# Autodesk Inventor assembly: Prototipo del Vehiculo instrumentado
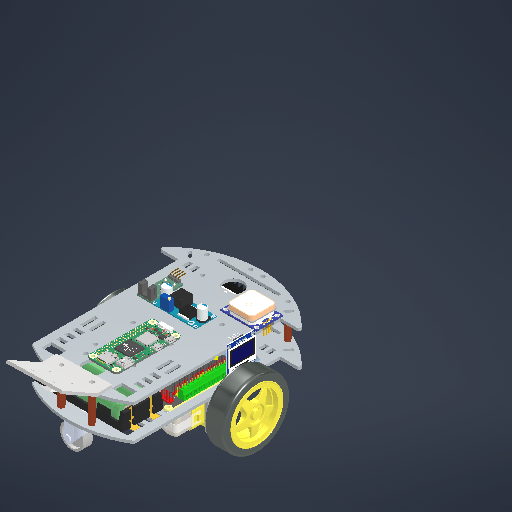
[picture p0: Inventor's stored thumbnail of the model, 512x512]
Saved by Autodesk Inventor 2026.1 (Build 301233020, 233B)
## iProperties
Created: 2026-08-15
Part Number: Prototipo del Vehiculo instrumentado
Document SubType Name: Assembly
Designer: allan
Author: allan
## Documents named in this file (17)
- C:\Users\allan\Downloads\Planos del vehiculo Instrumentado\Ensamble Final\Prototipo del Vehiculo instrumentado.iam
- C:\Users\allan\Downloads\Planos del vehiculo Instrumentado\Chasis con soporte rueda.ipt
- C:\Users\allan\Downloads\Planos del vehiculo Instrumentado\Moto Reductor - Rueda.iam
- C:\Users\allan\Downloads\Planos del vehiculo Instrumentado\Remache.ipt
- C:\Users\allan\Downloads\Planos del vehiculo Instrumentado\Chasis-Superior.ipt
- C:\Users\allan\Downloads\Planos del vehiculo Instrumentado\Rueda loca.ipt
- C:\Users\allan\Downloads\Planos del vehiculo Instrumentado\ESP32 Breakout Board SLDPRT.ipt
- C:\Users\allan\Downloads\Planos del vehiculo Instrumentado\Raspberry Pi Zero 2 W.ipt
- C:\Users\allan\Downloads\Planos del vehiculo Instrumentado\L298N.ipt
- C:\Users\allan\Downloads\Planos del vehiculo Instrumentado\2 Bateria de 18650 3.6 V 2500 mah.iam
- C:\Users\allan\Downloads\Planos del vehiculo Instrumentado\GPS-NEOM8N.iam
- C:\Users\allan\Downloads\Planos del vehiculo Instrumentado\Camara Raspberry OV5647.iam
- C:\Users\allan\Downloads\Planos del vehiculo Instrumentado\Soporte de Camara.ipt
- C:\Users\allan\Downloads\Planos del vehiculo Instrumentado\Regulador Lm2596.ipt
- C:\Users\allan\Downloads\Planos del vehiculo Instrumentado\OLED Display 0.96.ipt
- C:\Users\allan\Downloads\Planos del vehiculo Instrumentado\ADXL345.ipt
- C:\Users\allan\Downloads\Planos del vehiculo Instrumentado\Sensor Lm393.iam
## Components (20 placed, 16 different names)
1. Moto Reductor - Rueda:2 [sub-assembly] — Coincidencia:1, Coincidencia:2
2. Moto Reductor - Rueda:3 [sub-assembly] — Coincidencia:3
3. Chasis con soporte rueda:1 — Coincidencia:1, Coincidencia:2, Coincidencia:3, Coincidencia:4, Coincidencia:5, Coincidencia:6, Coincidencia:7, Coincidencia:14, Coincidencia:15, Coincidencia:34, Coincidencia:36, Coincidencia:37, Coincidencia:38, Coincidencia:43, Coincidencia:45, Coincidencia:46, Coincidencia:47, Coincidencia:48, Coincidencia:64
4. Remache:1 — Coincidencia:4, Coincidencia:5
5. Remache:2 — Coincidencia:6, Coincidencia:7, Coincidencia:12, Coincidencia:13
6. Chasis-Superior:1 — Coincidencia:12, Coincidencia:13, Coincidencia:18, Coincidencia:19, Coincidencia:27, Coincidencia:28, Coincidencia:29, Coincidencia:30, Coincidencia:33, Coincidencia:35, Coincidencia:51, Coincidencia:55, Coincidencia:56, Coincidencia:57, Coincidencia:58, Coincidencia:61, Coincidencia:63, Coincidencia:66
7. Rueda loca:1 — Coincidencia:14, Coincidencia:15
8. Raspberry Pi Zero 2 W:1 — Coincidencia:18, Coincidencia:19
9. Remache:3 — Coincidencia:27, Coincidencia:28, Coincidencia:34
10. Remache:4 — Coincidencia:29, Coincidencia:30
11. GPS-NEOM8N:1 [sub-assembly] — Coincidencia:33, Coincidencia:35, Coincidencia:51, Coincidencia:62
12. Camara Raspberry OV5647:1 [sub-assembly] — Coincidencia:59, Coincidencia:60
13. 2 Bateria de 18650 3.6 V 2500 mah:1 [sub-assembly] — Coincidencia:36, Coincidencia:37, Coincidencia:38, Coincidencia:44
14. ESP32 Breakout Board SLDPRT:1 — Coincidencia:43, Coincidencia:44, Coincidencia:45, Coincidencia:65
15. L298N:1 — Coincidencia:46, Coincidencia:47, Coincidencia:48
16. Regulador Lm2596:1 — Coincidencia:55, Coincidencia:56, Coincidencia:67, Coincidencia:68
17. Soporte de Camara:1 — Coincidencia:57, Coincidencia:58, Coincidencia:59, Coincidencia:60
18. OLED Display 0.96:1 — Coincidencia:61, Coincidencia:62, Coincidencia:63
19. ADXL345:1 — Coincidencia:64, Coincidencia:65
20. Sensor Lm393:1 [sub-assembly] — Coincidencia:66, Coincidencia:67, Coincidencia:68
## Relationships (44: Mate 44)
- Coincidencia:1 [Mate]: Moto Reductor - Rueda:2 ↔ Chasis con soporte rueda:1
- Coincidencia:2 [Mate]: Moto Reductor - Rueda:2 ↔ Chasis con soporte rueda:1
- Coincidencia:3 [Mate]: Moto Reductor - Rueda:3 ↔ Chasis con soporte rueda:1
- Coincidencia:4 [Mate]: Chasis con soporte rueda:1 ↔ Remache:1
- Coincidencia:5 [Mate]: Chasis con soporte rueda:1 ↔ Remache:1
- Coincidencia:6 [Mate]: Chasis con soporte rueda:1 ↔ Remache:2
- Coincidencia:7 [Mate]: Chasis con soporte rueda:1 ↔ Remache:2
- Coincidencia:12 [Mate]: Remache:2 ↔ Chasis-Superior:1
- Coincidencia:13 [Mate]: Remache:2 ↔ Chasis-Superior:1
- Coincidencia:14 [Mate]: Chasis con soporte rueda:1 ↔ Rueda loca:1
- Coincidencia:15 [Mate]: Chasis con soporte rueda:1 ↔ Rueda loca:1
- Coincidencia:18 [Mate]: Chasis-Superior:1 ↔ Raspberry Pi Zero 2 W:1
- Coincidencia:19 [Mate]: Chasis-Superior:1 ↔ Raspberry Pi Zero 2 W:1
- Coincidencia:27 [Mate]: Chasis-Superior:1 ↔ Remache:3
- Coincidencia:28 [Mate]: Chasis-Superior:1 ↔ Remache:3
- Coincidencia:29 [Mate]: Chasis-Superior:1 ↔ Remache:4
- Coincidencia:30 [Mate]: Chasis-Superior:1 ↔ Remache:4
- Coincidencia:33 [Mate]: Chasis-Superior:1 ↔ GPS-NEOM8N:1
- Coincidencia:34 [Mate]: Chasis con soporte rueda:1 ↔ Remache:3
- Coincidencia:35 [Mate]: Chasis-Superior:1 ↔ GPS-NEOM8N:1
- Coincidencia:36 [Mate]: Chasis con soporte rueda:1 ↔ 2 Bateria de 18650 3.6 V 2500 mah:1
- Coincidencia:37 [Mate]: Chasis con soporte rueda:1 ↔ 2 Bateria de 18650 3.6 V 2500 mah:1
- Coincidencia:38 [Mate]: Chasis con soporte rueda:1 ↔ 2 Bateria de 18650 3.6 V 2500 mah:1
- Coincidencia:43 [Mate]: Chasis con soporte rueda:1 ↔ ESP32 Breakout Board SLDPRT:1
- Coincidencia:44 [Mate]: 2 Bateria de 18650 3.6 V 2500 mah:1 ↔ ESP32 Breakout Board SLDPRT:1
- Coincidencia:45 [Mate]: Chasis con soporte rueda:1 ↔ ESP32 Breakout Board SLDPRT:1
- Coincidencia:46 [Mate]: Chasis con soporte rueda:1 ↔ L298N:1
- Coincidencia:47 [Mate]: Chasis con soporte rueda:1 ↔ L298N:1
- Coincidencia:48 [Mate]: Chasis con soporte rueda:1 ↔ L298N:1
- Coincidencia:51 [Mate]: Chasis-Superior:1 ↔ GPS-NEOM8N:1
- Coincidencia:55 [Mate]: Chasis-Superior:1 ↔ Regulador Lm2596:1
- Coincidencia:56 [Mate]: Chasis-Superior:1 ↔ Regulador Lm2596:1
- Coincidencia:57 [Mate]: Chasis-Superior:1 ↔ Soporte de Camara:1
- Coincidencia:58 [Mate]: Chasis-Superior:1 ↔ Soporte de Camara:1
- Coincidencia:59 [Mate]: Camara Raspberry OV5647:1 ↔ Soporte de Camara:1
- Coincidencia:60 [Mate]: Camara Raspberry OV5647:1 ↔ Soporte de Camara:1
- Coincidencia:61 [Mate]: Chasis-Superior:1 ↔ OLED Display 0.96:1
- Coincidencia:62 [Mate]: GPS-NEOM8N:1 ↔ OLED Display 0.96:1
- Coincidencia:63 [Mate]: Chasis-Superior:1 ↔ OLED Display 0.96:1
- Coincidencia:64 [Mate]: Chasis con soporte rueda:1 ↔ ADXL345:1
- Coincidencia:65 [Mate]: ESP32 Breakout Board SLDPRT:1 ↔ ADXL345:1
- Coincidencia:66 [Mate]: Chasis-Superior:1 ↔ Sensor Lm393:1
- Coincidencia:67 [Mate]: Regulador Lm2596:1 ↔ Sensor Lm393:1
- Coincidencia:68 [Mate]: Regulador Lm2596:1 ↔ Sensor Lm393:1
